# Autodesk Inventor assembly: cosmic-ray-detector-v2
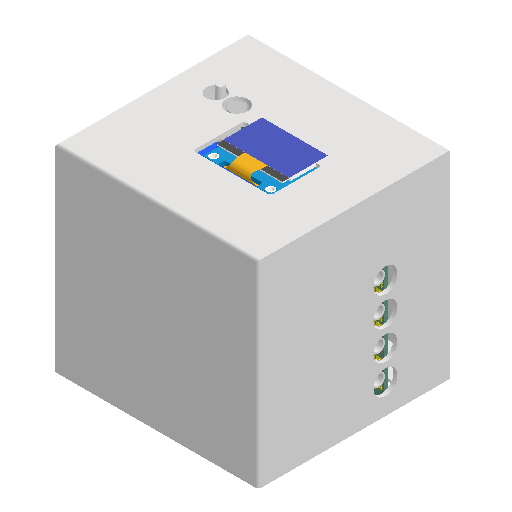
[picture p0: Inventor's stored thumbnail of the model, 512x512]
Saved by Autodesk Inventor 2025.2 (Build 292293000, 293)
## iProperties
Created: 2026-02-25
Part Number: cosmic-ray-detector-v2
Document SubType Name: Assembly
Designer: kaduo
Author: kaduo
## Documents named in this file (7)
- D:\Document\Research\software\pcb\cosmic-ray-detector\cosmic-ray-detector-v2\cad\cosmic-ray-detector-v2.iam
- D:\Document\Research\software\pcb\cosmic-ray-detector\cosmic-ray-detector-v2\cad\cosmic-ray-detector_splited\cosmic-ray-detector_splited\cosmic-ray-detector_splited.iam
- D:\Document\Research\software\pcb\cosmic-ray-detector\cosmic-ray-detector-v2\cad\cosmic-ray-detector_splited2\cosmic-ray-detector_splited2\cosmic-ray-detector_splited2.iam
- D:\Document\Research\software\pcb\cosmic-ray-detector\cosmic-ray-detector-v2\cad\scintillator.ipt
- D:\Document\Research\software\pcb\cosmic-ray-detector\cosmic-ray-detector-v2\cad\SH-SSLCB4-15.ipt
- D:\Document\Research\software\pcb\cosmic-ray-detector\cosmic-ray-detector-v2\cad\cosmic-ray-detector-v2-enclosure-fdm-body.ipt
- D:\Document\Research\software\pcb\cosmic-ray-detector\cosmic-ray-detector-v2\cad\cosmic-ray-detector-v2-enclosure-fdm-endplate.ipt
## Components (8 placed, 6 different names)
1. cosmic-ray-detector_splited:1 [sub-assembly] — Mate:22, Mate:23, Mate:24, Mate:27, Mate:29, Mate:31, Mate:32, Mate:33, Mate:34
2. cosmic-ray-detector_splited2:1 [sub-assembly] — Mate:4, Flush:1, Flush:2, Mate:22, Mate:23, Mate:24
3. scintillator:1 — Mate:4, Flush:1, Flush:2
4. SH-SSLCB4-15:1 — Mate:30, Mate:31, Mate:34, Mate:35
5. SH-SSLCB4-15:2 — Mate:27, Mate:29, Mate:36
6. SH-SSLCB4-15:3 — Mate:32, Mate:33
7. cosmic-ray-detector-v2-enclosure-fdm-body:1 — Mate:30, Mate:35, Mate:36, Flush:3, Flush:4, Flush:5, Mate:37
8. cosmic-ray-detector-v2-enclosure-fdm-endplate:1 — Flush:3, Flush:4
## Relationships (19: Mate 14, Flush 5)
- Mate:4: cosmic-ray-detector_splited2:1 ↔ scintillator:1
- Flush:1 (-5 mm): cosmic-ray-detector_splited2:1 ↔ scintillator:1
- Flush:2 (-5 mm): cosmic-ray-detector_splited2:1 ↔ scintillator:1
- Mate:22: cosmic-ray-detector_splited:1 ↔ cosmic-ray-detector_splited2:1
- Mate:23: cosmic-ray-detector_splited:1 ↔ cosmic-ray-detector_splited2:1
- Mate:24: cosmic-ray-detector_splited:1 ↔ cosmic-ray-detector_splited2:1
- Mate:27: cosmic-ray-detector_splited:1 ↔ SH-SSLCB4-15:2
- Mate:29: cosmic-ray-detector_splited:1 ↔ SH-SSLCB4-15:2
- Mate:30: SH-SSLCB4-15:1 ↔ cosmic-ray-detector-v2-enclosure-fdm-body:1
- Mate:31: cosmic-ray-detector_splited:1 ↔ SH-SSLCB4-15:1
- Mate:32: cosmic-ray-detector_splited:1 ↔ SH-SSLCB4-15:3
- Mate:33: cosmic-ray-detector_splited:1 ↔ SH-SSLCB4-15:3
- Mate:34: cosmic-ray-detector_splited:1 ↔ SH-SSLCB4-15:1
- Mate:35: SH-SSLCB4-15:1 ↔ cosmic-ray-detector-v2-enclosure-fdm-body:1
- Mate:36: SH-SSLCB4-15:2 ↔ cosmic-ray-detector-v2-enclosure-fdm-body:1
- Flush:3: cosmic-ray-detector-v2-enclosure-fdm-body:1 ↔ cosmic-ray-detector-v2-enclosure-fdm-endplate:1
- Flush:4: cosmic-ray-detector-v2-enclosure-fdm-body:1 ↔ cosmic-ray-detector-v2-enclosure-fdm-endplate:1
- Flush:5: cosmic-ray-detector-v2-enclosure-fdm-body:1
- Mate:37: cosmic-ray-detector-v2-enclosure-fdm-body:1
